# Autodesk Inventor assembly: feflinar_mai_inalt
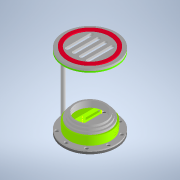
[picture p0: Inventor's stored thumbnail of the model, 180x180]
Saved by Autodesk Inventor 2022.6 (Build 266554000, 554)
## iProperties
Created: 2025-09-01
Part Number: feflinar_mai_inalt
Document SubType Name: Assembly
Designer: Dragos Macovei
Author: Dragos Macovei
## Documents named in this file (13)
- C:\Users\Dragos Macovei\Documents\Inventor_3d_parts\Felinar_mai_inalt\feflinar_mai_inalt.iam
- C:\Users\Dragos Macovei\Documents\Inventor_3d_parts\Felinar_mai_inalt\1_fund_felinar_6mm_mdf.ipt
- C:\Users\Dragos Macovei\Documents\Inventor_3d_parts\Felinar_mai_inalt\2_flansa_fixare_bete_verticale.ipt
- C:\Users\Dragos Macovei\Documents\Inventor_3d_parts\Felinar_mai_inalt\3_flansa_fixare_bete_verticale_sus_4mm.ipt
- C:\Users\Dragos Macovei\Documents\Inventor_3d_parts\Felinar_mai_inalt\4_4_capac_nr_4_6_mm.ipt
- C:\Users\Dragos Macovei\Documents\Inventor_3d_parts\Felinar_mai_inalt\5_inel_sus.ipt
- C:\Users\Dragos Macovei\Documents\Inventor_3d_parts\Felinar\cep.ipt
- C:\Users\Dragos Macovei\Documents\Inventor_3d_parts\Felinar_mai_inalt\suport_lumanare_3.ipt
- C:\Users\Dragos Macovei\Documents\Inventor_3d_parts\Felinar_mai_inalt\suport_lumanare_4.ipt
- C:\Users\Dragos Macovei\Documents\Inventor_3d_parts\Felinar_mai_inalt\suport_lumanare_5.ipt
- C:\Users\Dragos Macovei\Documents\Inventor_3d_parts\Felinar_mai_inalt\inglobare_baterie_6mm_.ipt
- C:\Users\Dragos Macovei\Documents\Inventor_3d_parts\Felinar_mai_inalt\inglobare_baterie_6mm_cu_buton_bun_.ipt
- C:\Users\Dragos Macovei\Documents\Inventor_3d_parts\Felinar_mai_inalt\fund_rfid.ipt
## Components (14 placed, 12 different names)
1. 1_fund_felinar_6mm_mdf:1 — Mate:1, Mate:2, Mate:10, Mate:27
2. 2_flansa_fixare_bete_verticale:1 — Mate:1, Mate:2, Mate:4, Mate:9, Mate:17, Mate:26, Mate:28
3. 3_flansa_fixare_bete_verticale_sus_4mm:1 — Mate:4, Mate:5, Mate:6
4. 4_4_capac_nr_4_6_mm:1 — Mate:5, Mate:6, Mate:7, Mate:8, Mate:11
5. 5_inel_sus:1 — Mate:7, Mate:8
6. cep:1 — Mate:9, Mate:10, Mate:11
7. suport_lumanare_3:1 — Mate:12, Mate:15, Mate:24, Mate:25
8. suport_lumanare_4:1 — Mate:12, Mate:13, Mate:14, Mate:15
9. suport_lumanare_5:1 — Mate:13, Mate:14
10. inglobare_baterie_6mm_:1 — Mate:20, Mate:23, Mate:24, Mate:25
11. inglobare_baterie_6mm_:2 — Mate:19, Mate:20, Mate:22, Mate:23
12. inglobare_baterie_6mm_:3 — Mate:17, Mate:18, Mate:21, Mate:26
13. inglobare_baterie_6mm_cu_buton_bun_:1 — Mate:18, Mate:19, Mate:21, Mate:22
14. fund_rfid:1 — Mate:27, Mate:28
## Relationships (26: Mate 26)
- Mate:1: 1_fund_felinar_6mm_mdf:1 ↔ 2_flansa_fixare_bete_verticale:1
- Mate:2: 1_fund_felinar_6mm_mdf:1 ↔ 2_flansa_fixare_bete_verticale:1
- Mate:4: 2_flansa_fixare_bete_verticale:1 ↔ 3_flansa_fixare_bete_verticale_sus_4mm:1
- Mate:5: 3_flansa_fixare_bete_verticale_sus_4mm:1 ↔ 4_4_capac_nr_4_6_mm:1
- Mate:6: 3_flansa_fixare_bete_verticale_sus_4mm:1 ↔ 4_4_capac_nr_4_6_mm:1
- Mate:7: 4_4_capac_nr_4_6_mm:1 ↔ 5_inel_sus:1
- Mate:8: 4_4_capac_nr_4_6_mm:1 ↔ 5_inel_sus:1
- Mate:9: 2_flansa_fixare_bete_verticale:1 ↔ cep:1
- Mate:10: 1_fund_felinar_6mm_mdf:1 ↔ cep:1
- Mate:11: 4_4_capac_nr_4_6_mm:1 ↔ cep:1
- Mate:12: suport_lumanare_3:1 ↔ suport_lumanare_4:1
- Mate:13: suport_lumanare_4:1 ↔ suport_lumanare_5:1
- Mate:14: suport_lumanare_4:1 ↔ suport_lumanare_5:1
- Mate:15: suport_lumanare_3:1 ↔ suport_lumanare_4:1
- Mate:17: 2_flansa_fixare_bete_verticale:1 ↔ inglobare_baterie_6mm_:3
- Mate:18: inglobare_baterie_6mm_:3 ↔ inglobare_baterie_6mm_cu_buton_bun_:1
- Mate:19: inglobare_baterie_6mm_:2 ↔ inglobare_baterie_6mm_cu_buton_bun_:1
- Mate:20: inglobare_baterie_6mm_:1 ↔ inglobare_baterie_6mm_:2
- Mate:21: inglobare_baterie_6mm_:3 ↔ inglobare_baterie_6mm_cu_buton_bun_:1
- Mate:22: inglobare_baterie_6mm_:2 ↔ inglobare_baterie_6mm_cu_buton_bun_:1
- Mate:23: inglobare_baterie_6mm_:1 ↔ inglobare_baterie_6mm_:2
- Mate:24: suport_lumanare_3:1 ↔ inglobare_baterie_6mm_:1
- Mate:25: suport_lumanare_3:1 ↔ inglobare_baterie_6mm_:1
- Mate:26: 2_flansa_fixare_bete_verticale:1 ↔ inglobare_baterie_6mm_:3
- Mate:27: 1_fund_felinar_6mm_mdf:1 ↔ fund_rfid:1
- Mate:28: 2_flansa_fixare_bete_verticale:1 ↔ fund_rfid:1
